# Autodesk Inventor assembly: robotfish_new_1
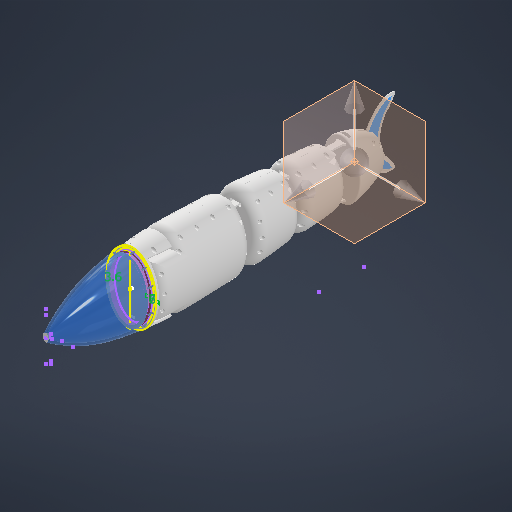
[picture p0: Inventor's stored thumbnail of the model, 512x512]
Saved by Autodesk Inventor 2027 (Build 310192060, 192F)
## iProperties
Created: 2026-09-06
Part Number: robotfish_new_1
Document SubType Name: Assembly
Designer: thita
Mass: 179 g
Surface Area: 280.46 cm^2
Volume: 221.383 cm^3
Sending System: Autodesk Inventor 2027
Preprocessor: ST-DEVELOPER v20.1
Title: robotfish_newest_1.stp
Author: Laptop
## Documents named in this file (22)
- D:\Year2\đồ án tốt nghịp\đồ án tốt nghiệp v2\đồ án tốt nghiệp v3\FULL_FISH_1\FULL_FISH_1\Workgroups\NotInProject\robotfish_newest_1.iam
- D:\Year2\đồ án tốt nghịp\đồ án tốt nghiệp v2\đồ án tốt nghiệp v3\FULL_FISH_1\FULL_FISH_1\Workgroups\NotInProject\thanh lk.ipt
- D:\Year2\đồ án tốt nghịp\đồ án tốt nghiệp v2\đồ án tốt nghiệp v3\FULL_FISH_1\FULL_FISH_1\Workgroups\NotInProject\thanh lk 1.ipt
- D:\Year2\đồ án tốt nghịp\đồ án tốt nghiệp v2\đồ án tốt nghiệp v3\FULL_FISH_1\FULL_FISH_1\Workgroups\NotInProject\manh_tren_truc_2.ipt
- D:\Year2\đồ án tốt nghịp\đồ án tốt nghiệp v2\đồ án tốt nghiệp v3\FULL_FISH_1\FULL_FISH_1\Workgroups\NotInProject\manh_tren_truc_3.ipt
- D:\Year2\đồ án tốt nghịp\đồ án tốt nghiệp v2\đồ án tốt nghiệp v3\FULL_FISH_1\FULL_FISH_1\Workgroups\NotInProject\hop v3.iam
- D:\Year2\đồ án tốt nghịp\đồ án tốt nghiệp v2\đồ án tốt nghiệp v3\FULL_FISH_1\FULL_FISH_1\Workgroups\NotInProject\Assembly1.iam
- D:\Year2\đồ án tốt nghịp\đồ án tốt nghiệp v2\đồ án tốt nghiệp v3\FULL_FISH_1\FULL_FISH_1\Workgroups\NotInProject\thanh lk 2.ipt
- D:\Year2\đồ án tốt nghịp\đồ án tốt nghiệp v2\đồ án tốt nghiệp v3\FULL_FISH_1\FULL_FISH_1\Workgroups\NotInProject\thanh lk 4.ipt
- D:\Year2\đồ án tốt nghịp\đồ án tốt nghiệp v2\đồ án tốt nghiệp v3\FULL_FISH_1\FULL_FISH_1\Workgroups\NotInProject\thanhlk 3.ipt
- D:\Year2\đồ án tốt nghịp\đồ án tốt nghiệp v2\đồ án tốt nghiệp v3\FULL_FISH_1\FULL_FISH_1\Workgroups\NotInProject\thanhlk 5.ipt
- D:\Year2\đồ án tốt nghịp\đồ án tốt nghiệp v2\đồ án tốt nghiệp v3\FULL_FISH_1\FULL_FISH_1\Workgroups\NotInProject\vây đuôi phương án A.ipt
- D:\Year2\đồ án tốt nghịp\đồ án tốt nghiệp v2\đồ án tốt nghiệp v3\FULL_FISH_1\FULL_FISH_1\Workgroups\NotInProject\rigid_tailtail.ipt
- D:\Year2\đồ án tốt nghịp\đồ án tốt nghiệp v2\đồ án tốt nghiệp v3\FULL_FISH_1\FULL_FISH_1\Workgroups\NotInProject\segment3.ipt
- D:\Year2\đồ án tốt nghịp\đồ án tốt nghiệp v2\đồ án tốt nghiệp v3\FULL_FISH_1\FULL_FISH_1\Workgroups\NotInProject\truc_khop_3_MIR.ipt
- D:\Year2\đồ án tốt nghịp\đồ án tốt nghiệp v2\đồ án tốt nghiệp v3\FULL_FISH_1\FULL_FISH_1\Workgroups\NotInProject\Pin 7.8Ah.ipt
- D:\Year2\đồ án tốt nghịp\đồ án tốt nghiệp v2\đồ án tốt nghiệp v3\FULL_FISH_1\FULL_FISH_1\Workgroups\NotInProject\dau_robot.iam
- D:\Year2\đồ án tốt nghịp\đồ án tốt nghiệp v2\đồ án tốt nghiệp v3\FULL_FISH_1\FULL_FISH_1\Workgroups\NotInProject\seg2_TRAI.ipt
- D:\Year2\đồ án tốt nghịp\đồ án tốt nghiệp v2\đồ án tốt nghiệp v3\FULL_FISH_1\FULL_FISH_1\Workgroups\NotInProject\seg1_TRAI.ipt
- D:\Year2\đồ án tốt nghịp\đồ án tốt nghiệp v2\đồ án tốt nghiệp v3\FULL_FISH_1\FULL_FISH_1\Workgroups\NotInProject\seg3_TRAI.ipt
- D:\Year2\đồ án tốt nghịp\đồ án tốt nghiệp v2\đồ án tốt nghiệp v3\FULL_FISH_1\FULL_FISH_1\Workgroups\NotInProject\seg2_PHAI.ipt
- D:\Year2\đồ án tốt nghịp\đồ án tốt nghiệp v2\đồ án tốt nghiệp v3\FULL_FISH_1\FULL_FISH_1\Workgroups\NotInProject\seg1_PHAI.ipt
## Components (22 placed, 21 different names)
1. thanh lk:1 — Rigid:7
2. thanh lk 1:1 — Rigid:11
3. manh_tren_truc_2:1 — Rigid:2, Rigid:3
4. manh_tren_truc_3:1 — Rigid:1, Rigid:2
5. hop v3:13 [sub-assembly] — Rigid:7, Rigid:8
6. hop v3:14 [sub-assembly] — Rigid:11, Rigid:13
7. Assembly1:17 [sub-assembly] — Rigid:5
8. thanh lk 2:1 — Rigid:15
9. thanh lk 4:2 — Rigid:10, Rotational:16
10. thanhlk 3:2 — Rotational:4, Rigid:14
11. thanhlk 5:2 — Rotational:3, Rigid:16
12. vây đuôi phương án A:2 — Rigid:17
13. rigid_tailtail:3 — Rigid:15, Rigid:16, Rigid:17
14. segment3:4 — Rigid:10, Rigid:12, Rigid:13, Rotational:3
15. truc_khop_3_MIR:2
16. Pin 7.8Ah:1 — Rigid:18
17. dau_robot:1 [sub-assembly] — Rigid:1
18. seg2_TRAI:1 — Rigid:9
19. seg1_TRAI:1 — Rigid:6
20. seg3_TRAI:1 — Rigid:12
21. seg2_PHAI:1 — Rigid:8, Rigid:9, Rigid:14, Rotational:16
22. seg1_PHAI:1 — Rigid:3, Rigid:5, Rigid:6, Rotational:4, Rigid:18
## Relationships (20: WeldJoint 17, RevoluteJoint 3)
- Rigid:1 [WeldJoint]: manh_tren_truc_3:1 ↔ dau_robot:1
- Rigid:2 [WeldJoint]: manh_tren_truc_2:1 ↔ manh_tren_truc_3:1
- Rigid:3 [WeldJoint]: manh_tren_truc_2:1 ↔ seg1_PHAI:1
- Rigid:5 [WeldJoint]: Assembly1:17 ↔ seg1_PHAI:1
- Rigid:6 [WeldJoint]: seg1_TRAI:1 ↔ seg1_PHAI:1
- Rigid:7 [WeldJoint]: thanh lk:1 ↔ hop v3:13
- Rigid:8 [WeldJoint]: hop v3:13 ↔ seg2_PHAI:1
- Rigid:9 [WeldJoint]: seg2_TRAI:1 ↔ seg2_PHAI:1
- Rigid:10 [WeldJoint]: thanh lk 4:2 ↔ segment3:4
- Rigid:11 [WeldJoint]: thanh lk 1:1 ↔ hop v3:14
- Rigid:12 [WeldJoint]: segment3:4 ↔ seg3_TRAI:1
- Rigid:13 [WeldJoint]: hop v3:14 ↔ segment3:4
- Rotational:3 [RevoluteJoint]: thanhlk 5:2 ↔ segment3:4
- Rotational:4 [RevoluteJoint]: thanhlk 3:2 ↔ seg1_PHAI:1
- Rigid:14 [WeldJoint]: thanhlk 3:2 ↔ seg2_PHAI:1
- Rotational:16 [RevoluteJoint]: thanh lk 4:2 ↔ seg2_PHAI:1
- Rigid:15 [WeldJoint]: thanh lk 2:1 ↔ rigid_tailtail:3
- Rigid:16 [WeldJoint]: thanhlk 5:2 ↔ rigid_tailtail:3
- Rigid:17 [WeldJoint]: vây đuôi phương án A:2 ↔ rigid_tailtail:3
- Rigid:18 [WeldJoint]: Pin 7.8Ah:1 ↔ seg1_PHAI:1
